# Autodesk Inventor assembly: 荷叶模块_2
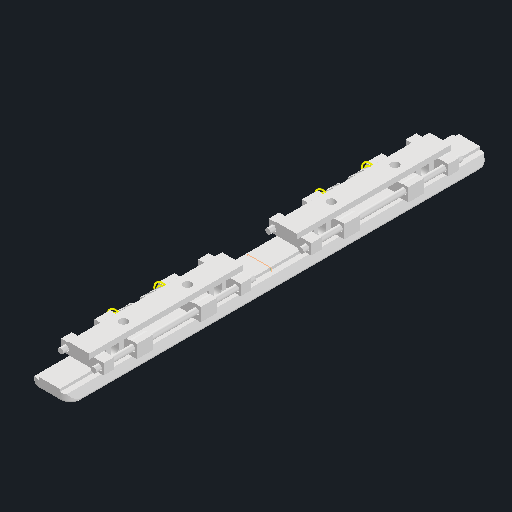
[picture p0: Inventor's stored thumbnail of the model, 512x512]
Saved by Autodesk Inventor 2025 (Build 290162000, 162)
## iProperties
Created: 2025-08-27
Part Number: 荷叶模块_2
Document SubType Name: Assembly
Designer: HZD
Author: HZD
## Documents named in this file (4)
- D:\2 B Mechanical design\有光\铰链\荷叶模块_2.iam
- D:\2 B Mechanical design\有光\铰链\扭力装配体_2.iam
- D:\2 B Mechanical design\有光\铰链\扭力模块板1_2.ipt
- D:\2 B Mechanical design\有光\铰链\扭力模块板_2.ipt
## Components (5 placed, 3 different names)
1. 扭力装配体_2:1 [sub-assembly] — 配合:18, 配合:17, 配合:16
2. 扭力模块板1_2:1 — 配合:18, 配合:17, 配合:16, 对称:1
3. 扭力装配体_2:2 [sub-assembly] — 配合:22, 配合:21, 配合:20
4. 扭力模块板1_2:2 — 配合:22, 配合:21, 配合:20, 对称:1
5. 扭力模块板_2:1
## Relationships (7: Mate 6, Symmetry 1)
- 配合:18 [Mate]: 扭力装配体_2:1 ↔ 扭力模块板1_2:1
- 配合:17 [Mate]: 扭力装配体_2:1 ↔ 扭力模块板1_2:1
- 配合:16 [Mate]: 扭力装配体_2:1 ↔ 扭力模块板1_2:1
- 配合:22 [Mate]: 扭力装配体_2:2 ↔ 扭力模块板1_2:2
- 配合:21 [Mate]: 扭力装配体_2:2 ↔ 扭力模块板1_2:2
- 配合:20 [Mate]: 扭力装配体_2:2 ↔ 扭力模块板1_2:2
- 对称:1 [Symmetry]: 扭力模块板1_2:1 ↔ 扭力模块板1_2:2
